# Autodesk Inventor assembly: UAV_Assembly
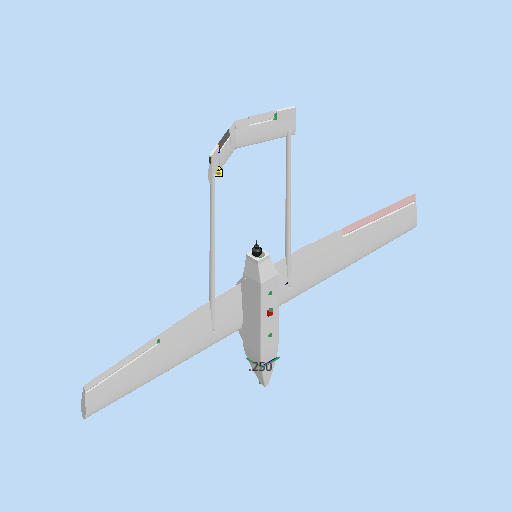
[picture p0: Inventor's stored thumbnail of the model, 512x512]
Saved by Autodesk Inventor 2026.1 (Build 301233000, 233)
## iProperties
Created: 2025-03-16
Part Number: UAV_Assembly
Document SubType Name: Assembly
Designer: Cupri
Author: Cupri
## Documents named in this file (33)
- C:\GitHub\SWIFT-UAV\System_development\Pelican\structural_model\v0.1.0\UAVDesign\UAV_Assembly_v0.3.0\UAV_Assembly.iam
- C:\GitHub\SWIFT-UAV\System_development\Pelican\structural_model\v0.1.0\UAVDesign\UAV_Assembly_v0.3.0\KDEXF-UAS125AUHV ESC.iam
- C:\GitHub\SWIFT-UAV\System_development\Pelican\structural_model\v0.1.0\UAVDesign\UAV_Assembly_v0.3.0\PIXHAWK 5X-6X.ipt
- C:\GitHub\SWIFT-UAV\System_development\Pelican\structural_model\v0.1.0\UAVDesign\UAV_Assembly_v0.3.0\PIXHAWK 6C MINI.ipt
- C:\GitHub\SWIFT-UAV\System_development\Pelican\structural_model\v0.1.0\UAVDesign\UAV_Assembly_v0.3.0\PM03D Power Module.ipt
- C:\GitHub\SWIFT-UAV\System_development\Pelican\structural_model\v0.1.0\UAVDesign\UAV_Assembly_v0.3.0\KV200_T_Motor.ipt
- C:\GitHub\SWIFT-UAV\System_development\Pelican\structural_model\v0.1.0\UAVDesign\UAV_Assembly_v0.3.0\Walksnail 4K Moonlight.ipt
- C:\GitHub\SWIFT-UAV\System_development\Pelican\structural_model\v0.1.0\UAVDesign\UAV_Assembly_v0.3.0\Avatar TX1S V3.ipt
- C:\GitHub\SWIFT-UAV\System_development\Pelican\structural_model\v0.1.0\UAVDesign\UAV_Assembly_v0.3.0\Liperior_13000mAh_Battery.ipt
- C:\GitHub\SWIFT-UAV\System_development\Pelican\structural_model\v0.1.0\UAVDesign\UAV_Assembly_v0.3.0\MATEKSYS_12S_Pro.ipt
- C:\GitHub\SWIFT-UAV\System_development\Pelican\structural_model\v0.1.0\UAVDesign\UAV_Assembly_v0.3.0\Sensor_Release_Magnet.ipt
- C:\GitHub\SWIFT-UAV\System_development\Pelican\structural_model\v0.1.0\UAVDesign\UAV_Assembly_v0.3.0\Holybro GPS.ipt
- C:\GitHub\SWIFT-UAV\System_development\Pelican\structural_model\v0.1.0\UAVDesign\UAV_Assembly_v0.3.0\Telemetry Holybro A.ipt
- C:\GitHub\SWIFT-UAV\System_development\Pelican\structural_model\v0.1.0\UAVDesign\UAV_Assembly_v0.3.0\Fuselage_Nose_Piece.ipt
- C:\GitHub\SWIFT-UAV\System_development\Pelican\structural_model\v0.1.0\UAVDesign\UAV_Assembly_v0.3.0\Fuselage_Body_Piece.ipt
- C:\GitHub\SWIFT-UAV\System_development\Pelican\structural_model\v0.1.0\UAVDesign\UAV_Assembly_v0.3.0\Fuselage_Engine_Housing_Piece.ipt
- C:\GitHub\SWIFT-UAV\System_development\Pelican\structural_model\v0.1.0\UAVDesign\UAV_Assembly_v0.3.0\MiddleWingL.ipt
- C:\GitHub\SWIFT-UAV\System_development\Pelican\structural_model\v0.1.0\UAVDesign\UAV_Assembly_v0.3.0\MiddleWingL_MIR.ipt
- C:\GitHub\SWIFT-UAV\System_development\Pelican\structural_model\v0.1.0\UAVDesign\UAV_Assembly_v0.3.0\WingBoomReinforcment.ipt
- C:\GitHub\SWIFT-UAV\System_development\Pelican\structural_model\v0.1.0\UAVDesign\UAV_Assembly_v0.3.0\WingBoomReinforcment_MIR.ipt
- C:\GitHub\SWIFT-UAV\System_development\Pelican\structural_model\v0.1.0\UAVDesign\UAV_Assembly_v0.3.0\Boom.ipt
- C:\GitHub\SWIFT-UAV\System_development\Pelican\structural_model\v0.1.0\UAVDesign\UAV_Assembly_v0.3.0\KST_DS215MG_MIR.ipt
- C:\GitHub\SWIFT-UAV\System_development\Pelican\structural_model\v0.1.0\UAVDesign\UAV_Assembly_v0.3.0\WingMotorPlate.ipt
- C:\GitHub\SWIFT-UAV\System_development\Pelican\structural_model\v0.1.0\UAVDesign\UAV_Assembly_v0.3.0\WingMotorPlate_MIR.ipt
- C:\GitHub\SWIFT-UAV\System_development\Pelican\structural_model\v0.1.0\UAVDesign\UAV_Assembly_v0.3.0\Boom_MIR.ipt
- C:\GitHub\SWIFT-UAV\System_development\Pelican\structural_model\v0.1.0\UAVDesign\UAV_Assembly_v0.3.0\LeftAlerion.ipt
- C:\GitHub\SWIFT-UAV\System_development\Pelican\structural_model\v0.1.0\UAVDesign\UAV_Assembly_v0.3.0\WingCap.ipt
- C:\GitHub\SWIFT-UAV\System_development\Pelican\structural_model\v0.1.0\UAVDesign\UAV_Assembly_v0.3.0\LeftAlerion_MIR.ipt
- C:\GitHub\SWIFT-UAV\System_development\Pelican\structural_model\v0.1.0\UAVDesign\UAV_Assembly_v0.3.0\WingCap_MIR.ipt
- C:\GitHub\SWIFT-UAV\System_development\Pelican\structural_model\v0.1.0\UAVDesign\UAV_Assembly_v0.3.0\WingBox.ipt
- C:\GitHub\SWIFT-UAV\System_development\Pelican\structural_model\v0.1.0\UAVDesign\UAV_Assembly_v0.3.0\TailV3.iam
- C:\GitHub\SWIFT-UAV\System_development\Pelican\structural_model\v0.1.0\UAVDesign\UAV_Assembly_v0.3.0\Spar.ipt
- C:\GitHub\SWIFT-UAV\System_development\Pelican\structural_model\v0.1.0\UAVDesign\UAV_Assembly_v0.3.0\Spar_MIR.ipt
## Components (35 placed, 32 different names)
1. KDEXF-UAS125AUHV ESC:1 [sub-assembly]
2. PIXHAWK 5X-6X:1
3. PIXHAWK 6C MINI:1
4. PM03D Power Module:1
5. KV200_T_Motor:1
6. Walksnail 4K Moonlight:1
7. Avatar TX1S V3:1
8. Liperior_13000mAh_Battery:1
9. MATEKSYS_12S_Pro:1
10. Sensor_Release_Magnet:1
11. Holybro GPS:1
12. Telemetry Holybro A:1
13. Fuselage_Nose_Piece:1
14. Fuselage_Body_Piece:1 — Mate:38, Flush:10
15. Fuselage_Body_Piece:2
16. Fuselage_Body_Piece:3 — Mate:39
17. Fuselage_Engine_Housing_Piece:1
18. MiddleWingL:1 — Mate:31, Mate:32, Symmetry:1, Mate:33, Mate:35, Mate:36, Mate:37, Flush:4, Flush:5, Flush:8, Flush:9, Symmetry:2, Mate:63
19. MiddleWingL_MIR:1 — Symmetry:1
20. WingBoomReinforcment:1 — Mate:31, Mate:32, Mate:34
21. WingBoomReinforcment_MIR:1 — Mate:57
22. Boom:1 — Mate:33, Mate:34, Mate:58, Mate:60
23. KST_DS215MG_MIR:1 — Mate:35, Mate:36, Mate:37
24. WingMotorPlate:1 — Flush:4, Flush:5, Flush:6, Flush:7
25. WingMotorPlate_MIR:1
26. Boom_MIR:1 — Mate:57, Mate:59, Mate:61
27. KST_DS215MG_MIR:1
28. LeftAlerion:1 — Flush:6, Flush:7
29. WingCap:1 — Flush:8, Flush:9
30. LeftAlerion_MIR:1
31. WingCap_MIR:1
32. WingBox:1 — Mate:38, Flush:10, Mate:39, Symmetry:2
33. TailV3:1 [sub-assembly] — Mate:58, Mate:59, Mate:60, Mate:61, Flush:11
34. Spar:1 — Mate:62, Mate:63
35. Spar_MIR:1 — Mate:64
## Relationships (46: Mate 35, Flush 9, Symmetry 2)
- [Mate]: Fuselage_Body_Piece:1 ↔ Fuselage_Body_Piece:2
- [Mate]: Fuselage_Body_Piece:1 ↔ Fuselage_Body_Piece:2
- [Mate]: Liperior_13000mAh_Battery:1 ↔ Fuselage_Body_Piece:2
- [Mate]: Liperior_13000mAh_Battery:1 ↔ Fuselage_Body_Piece:2
- [Mate]: PIXHAWK 5X-6X:1 ↔ Fuselage_Body_Piece:1
- [Mate]: PIXHAWK 6C MINI:1 ↔ Fuselage_Body_Piece:1
- [Mate]: Fuselage_Body_Piece:2 ↔ Fuselage_Body_Piece:3
- [Mate]: Fuselage_Body_Piece:2 ↔ Fuselage_Body_Piece:3
- [Mate]: Fuselage_Body_Piece:3 ↔ Fuselage_Engine_Housing_Piece:1
- [Mate]: Fuselage_Body_Piece:3 ↔ Fuselage_Engine_Housing_Piece:1
- [Mate]: Sensor_Release_Magnet:1 ↔ Fuselage_Body_Piece:2
- [Mate]: KV200_T_Motor:1 ↔ Fuselage_Engine_Housing_Piece:1
- [Mate]: KDEXF-UAS125AUHV ESC:1 ↔ Fuselage_Engine_Housing_Piece:1
- [Mate]: Avatar TX1S V3:1 ↔ Fuselage_Body_Piece:1
- [Mate]: Telemetry Holybro A:1 ↔ Fuselage_Body_Piece:1
- [Mate]: MATEKSYS_12S_Pro:1 ↔ Fuselage_Body_Piece:1
- [Mate]: PM03D Power Module:1 ↔ Fuselage_Body_Piece:3
- [Mate]: Fuselage_Nose_Piece:1 ↔ Fuselage_Body_Piece:1
- [Flush]: Fuselage_Nose_Piece:1 ↔ Fuselage_Body_Piece:1
- Mate:31: MiddleWingL:1 ↔ WingBoomReinforcment:1
- Mate:32: MiddleWingL:1 ↔ WingBoomReinforcment:1
- Symmetry:1: MiddleWingL:1 ↔ MiddleWingL_MIR:1
- Mate:33: MiddleWingL:1 ↔ Boom:1
- Mate:34: WingBoomReinforcment:1 ↔ Boom:1
- Mate:35: MiddleWingL:1 ↔ KST_DS215MG_MIR:1
- Mate:36: MiddleWingL:1 ↔ KST_DS215MG_MIR:1
- Mate:37: MiddleWingL:1 ↔ KST_DS215MG_MIR:1
- Flush:4: MiddleWingL:1 ↔ WingMotorPlate:1
- Flush:5: MiddleWingL:1 ↔ WingMotorPlate:1
- Flush:6: WingMotorPlate:1 ↔ LeftAlerion:1
- Flush:7: WingMotorPlate:1 ↔ LeftAlerion:1
- Flush:8: MiddleWingL:1 ↔ WingCap:1
- Flush:9: MiddleWingL:1 ↔ WingCap:1
- Mate:38: Fuselage_Body_Piece:1 ↔ WingBox:1
- Flush:10: Fuselage_Body_Piece:1 ↔ WingBox:1
- Mate:39: Fuselage_Body_Piece:3 ↔ WingBox:1
- Mate:57: WingBoomReinforcment_MIR:1 ↔ Boom_MIR:1
- Mate:58: Boom:1 ↔ TailV3:1
- Mate:59: Boom_MIR:1 ↔ TailV3:1
- Mate:60: Boom:1 ↔ TailV3:1
- Mate:61: Boom_MIR:1 ↔ TailV3:1
- Flush:11: TailV3:1
- Symmetry:2: MiddleWingL:1 ↔ WingBox:1
- Mate:62: Spar:1
- Mate:63: MiddleWingL:1 ↔ Spar:1
- Mate:64: Spar_MIR:1
## Named parameters: d7_d12 = 0 mm, d8_d13 = 0 mm, d9_d14 = 0 mm, d10_d15 = 0 mm, d11_d16 = 0 mm, d12_d17 = 0 mm, d13_d18 = 0 mm, d14_d19 = 0 mm, d15_d20 = 0 mm, d16_d21 = 0 mm, d17_d22 = 0 mm, d18_d23 = 0 mm, d19_d24 = 0 mm, d20_d25 = 0 mm, d21_d26 = 0 mm
